# Autodesk Inventor assembly: m6_70mm_t-slot_bolt_assembly
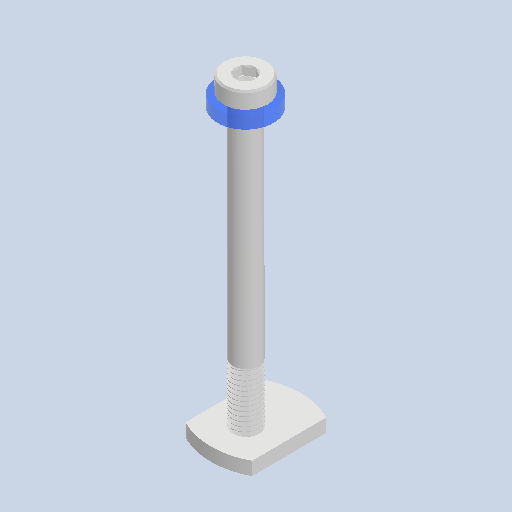
[picture p0: Inventor's stored thumbnail of the model, 512x512]
Saved by Autodesk Inventor 2025.1 (Build 291241000, 241)
## iProperties
Created: 2026-10-19
Part Number: m6_70mm_t-slot_bolt_assembly
Document SubType Name: Assembly
Designer: Aiden Shaevitz
Author: Aiden Shaevitz
## Documents named in this file (4)
- C:\Users\Aiden Shaevitz\Documents\GitHub\coldex-instrumentation\3d_models\mounting_hardware\dummy_parts\m6_70mm_t-slot_bolt_assembly.iam
- C:\Users\Aiden Shaevitz\Documents\GitHub\coldex-instrumentation\3d_models\mounting_hardware\McMaster\30mm_teenut_T-Slotted Framing.ipt
- C:\Users\Aiden Shaevitz\Documents\GitHub\coldex-instrumentation\3d_models\mounting_hardware\McMaster\m6_70mm_18-8 Stainless Steel Low-Profile Socket Head Screws.ipt
- C:\Users\Aiden Shaevitz\Documents\GitHub\coldex-instrumentation\3d_models\mounting_hardware\McMaster\0.257in_innerD_Moisture-Resistant Cushioning Washer.ipt
## Components (3 placed, 3 different names)
1. 30mm_teenut_T-Slotted Framing:1
2. m6_70mm_18-8 Stainless Steel Low-Profile Socket Head Screws:1
3. 0.257in_innerD_Moisture-Resistant Cushioning Washer:1
## Relationships (3: Mate 3)
- [Mate]: 30mm_teenut_T-Slotted Framing:1 ↔ m6_70mm_18-8 Stainless Steel Low-Profile Socket Head Screws:1
- [Mate]: m6_70mm_18-8 Stainless Steel Low-Profile Socket Head Screws:1 ↔ 0.257in_innerD_Moisture-Resistant Cushioning Washer:1
- [Mate]: m6_70mm_18-8 Stainless Steel Low-Profile Socket Head Screws:1 ↔ 0.257in_innerD_Moisture-Resistant Cushioning Washer:1
